# Autodesk Inventor assembly: D0493
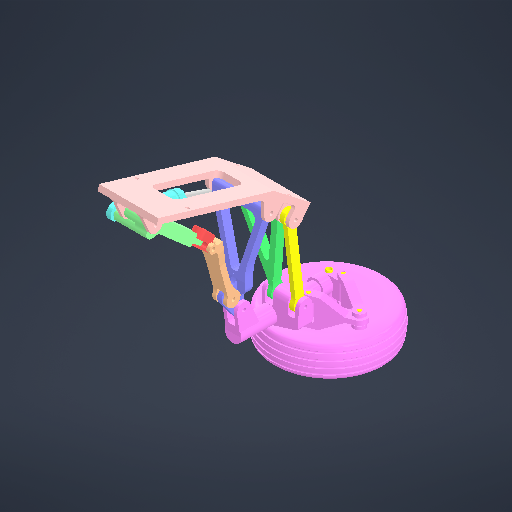
[picture p0: Inventor's stored thumbnail of the model, 512x512]
Saved by Autodesk Inventor 2027.1 (Build 311270010, 270A)
## iProperties
Created: 2026-10-18
Part Number: D0493
Description: STEP AP214
Document SubType Name: Assembly
Designer: USER
Sending System: Autodesk Translation Framework v15.15.0.0
Preprocessor: ST-DEVELOPER v20.2
Title: Landing Gear STEP.step
## Documents named in this file (11)
- C:\Users\USER\Desktop\Machinary Landing Gear\cad\Landing Gear STEP.iam
- C:\Users\USER\Desktop\Machinary Landing Gear\cad\Landing Gear STEP\Wheel.iam
- C:\Users\USER\Desktop\Machinary Landing Gear\cad\Landing Gear STEP\Yellow.iam
- C:\Users\USER\Desktop\Machinary Landing Gear\cad\Landing Gear STEP\Orange.ipt
- C:\Users\USER\Desktop\Machinary Landing Gear\cad\Landing Gear STEP\Purple.iam
- C:\Users\USER\Desktop\Machinary Landing Gear\cad\Landing Gear STEP\Red.ipt
- C:\Users\USER\Desktop\Machinary Landing Gear\cad\Landing Gear STEP\Piston1.iam
- C:\Users\USER\Desktop\Machinary Landing Gear\cad\Landing Gear STEP\Dark green.iam
- C:\Users\USER\Desktop\Machinary Landing Gear\cad\Landing Gear STEP\Piston2.iam
- C:\Users\USER\Desktop\Machinary Landing Gear\cad\Landing Gear STEP\Light green.ipt
- C:\Users\USER\Desktop\Machinary Landing Gear\cad\Landing Gear STEP\Base.ipt
## Components (10 placed, 10 different names)
1. Wheel:1 [sub-assembly] — Rotational:4, Rotational:5, Rotational:6
2. Yellow:1 [sub-assembly] — Rotational:1, Rotational:6
3. Orange:1 — Rotational:3, Cylindrical:7
4. Purple:1 [sub-assembly] — Rotational:3, Rotational:4, Rotational:7, Cylindrical:3
5. Red:1 — Cylindrical:6, Cylindrical:7, Rotational:8
6. Piston1:1 [sub-assembly] — Rotational:2, Cylindrical:1, Cylindrical:5
7. Dark green:1 [sub-assembly] — Rotational:5, Cylindrical:4
8. Piston2:1 [sub-assembly] — Cylindrical:1, Rotational:7, Cylindrical:5
9. Light green:1 — Rotational:2, Cylindrical:2, Cylindrical:6, Rotational:8
10. Base:1 — Rotational:1, Cylindrical:2, Cylindrical:3, Cylindrical:4
## Relationships (15: RevoluteJoint 8, CylindricalJoint 7)
- Rotational:1 [RevoluteJoint]: Yellow:1 ↔ Base:1
- Rotational:2 [RevoluteJoint]: Piston1:1 ↔ Light green:1
- Cylindrical:1: Piston1:1 ↔ Piston2:1
- Rotational:3 [RevoluteJoint]: Orange:1 ↔ Purple:1
- Rotational:4 [RevoluteJoint]: Wheel:1 ↔ Purple:1
- Rotational:5 [RevoluteJoint]: Wheel:1 ↔ Dark green:1
- Rotational:6 [RevoluteJoint]: Wheel:1 ↔ Yellow:1
- Rotational:7 [RevoluteJoint]: Purple:1 ↔ Piston2:1
- Cylindrical:2: Light green:1 ↔ Base:1
- Cylindrical:3: Purple:1 ↔ Base:1
- Cylindrical:4: Dark green:1 ↔ Base:1
- Cylindrical:5: Piston1:1 ↔ Piston2:1
- Cylindrical:6: Red:1 ↔ Light green:1
- Cylindrical:7: Orange:1 ↔ Red:1
- Rotational:8 [RevoluteJoint]: Red:1 ↔ Light green:1
